# Autodesk Inventor assembly: Torso_estudio_B
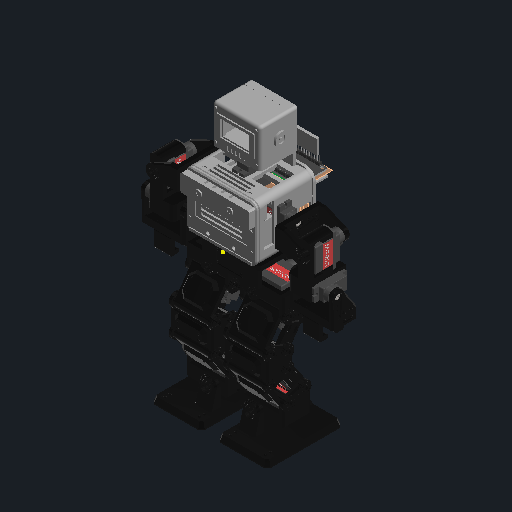
[picture p0: Inventor's stored thumbnail of the model, 512x512]
Saved by Autodesk Inventor 2027 (Build 310192060, 192F)
## iProperties
Part Number: Torso_estudio_B
Document SubType Name: Ensamblaje
Designer: rodri
Author: rodri
## Documents named in this file (31)
- C:\Users\rodri\Documents\PlatformIO\Projects\Proyecto Robot\CAD\Nuevo\Robot_armado_B.iam
- C:\Users\rodri\Documents\PlatformIO\Projects\Proyecto Robot\CAD\Nuevo\piezas_m3\Bracket01_B.ipt
- C:\Users\rodri\Documents\PlatformIO\Projects\Proyecto Robot\CAD\Nuevo\piezas_m3\Bracket03_B.ipt
- C:\Users\rodri\Documents\PlatformIO\Projects\Proyecto Robot\CAD\Nuevo\piezas_estilo\Bracket04_B.ipt
- C:\Users\rodri\Documents\PlatformIO\Projects\Proyecto Robot\CAD\Nuevo\piezas_estilo\Nee_B.ipt
- C:\Users\rodri\Documents\PlatformIO\Projects\Proyecto Robot\CAD\Nuevo\piezas_m3\Bracket02_W.ipt
- C:\Users\rodri\Documents\PlatformIO\Projects\Proyecto Robot\CAD\Nuevo\piezas_estilo\Link_W.ipt
- C:\Users\rodri\Documents\PlatformIO\Projects\Proyecto Robot\CAD\Nuevo\piezas_estilo\Bracket05_B.ipt
- C:\Users\rodri\Documents\PlatformIO\Projects\Proyecto Robot\CAD\Nuevo\piezas_m3\Spacer01_W.ipt
- C:\Users\rodri\Documents\PlatformIO\Projects\Proyecto Robot\CAD\Componentes\MG90S_grabcad_mg90s9.ipt
- C:\Users\rodri\Documents\PlatformIO\Projects\Proyecto Robot\CAD\Nuevo\piezas_estilo\Pelvis.ipt
- C:\Users\rodri\Documents\PlatformIO\Projects\Proyecto Robot\CAD\Nuevo\piezas_m3\Bracket07_B.ipt
- C:\Users\rodri\Documents\PlatformIO\Projects\Proyecto Robot\CAD\Nuevo\piezas_m3\Bracket09_W.ipt
- C:\Users\rodri\Documents\PlatformIO\Projects\Proyecto Robot\CAD\Nuevo\piezas_rediseno\Bracket11_B.ipt
- C:\Users\rodri\Documents\PlatformIO\Projects\Proyecto Robot\CAD\Nuevo\piezas_m3\Bracket08_B.ipt
- C:\Users\rodri\Documents\PlatformIO\Projects\Proyecto Robot\CAD\Nuevo\piezas_m3\Bracket10_W.ipt
- C:\Users\rodri\Documents\PlatformIO\Projects\Proyecto Robot\CAD\Nuevo\piezas_rediseno\Bracket12_B.ipt
- C:\Users\rodri\Documents\PlatformIO\Projects\Proyecto Robot\CAD\Componentes\PCA9685_adafruit_815.iam
- C:\Users\rodri\Documents\PlatformIO\Projects\Proyecto Robot\CAD\Componentes\ESP32_devkit_v1_30pin.iam
- C:\Users\rodri\Documents\PlatformIO\Projects\Proyecto Robot\CAD\Componentes\Bateria_LiPo_2S_1000_62x23x17.ipt
- C:\Users\rodri\Documents\PlatformIO\Projects\Proyecto Robot\CAD\Componentes\XL4015_52x12x24_acostado.ipt
- C:\Users\rodri\Documents\PlatformIO\Projects\Proyecto Robot\CAD\Componentes\IMU_GY521_21x16.ipt
- C:\Users\rodri\Documents\PlatformIO\Projects\Proyecto Robot\CAD\Componentes\Fichas_pines_IMU.ipt
- C:\Users\rodri\Documents\PlatformIO\Projects\Proyecto Robot\CAD\Componentes\Fichas_servos_PCA_atras.ipt
- C:\Users\rodri\Documents\PlatformIO\Projects\Proyecto Robot\CAD\Componentes\Fichas_pines_ESP32_atras14.ipt
- C:\Users\rodri\Documents\PlatformIO\Projects\Proyecto Robot\CAD\Nuevo\Torso_cuerpo_B.ipt
- C:\Users\rodri\Documents\PlatformIO\Projects\Proyecto Robot\CAD\Nuevo\Torso_pecho.ipt
- C:\Users\rodri\Documents\PlatformIO\Projects\Proyecto Robot\CAD\Nuevo\Torso_atras_B.ipt
- C:\Users\rodri\Documents\PlatformIO\Projects\Proyecto Robot\CAD\Nuevo\Cabeza_frente.ipt
- C:\Users\rodri\Documents\PlatformIO\Projects\Proyecto Robot\CAD\Nuevo\Cabeza_tapa.ipt
- C:\Users\rodri\Documents\PlatformIO\Projects\Proyecto Robot\CAD\Nuevo\piezas_m3\Pipe_M3.ipt
## Components (90 placed, 30 different names)
1. Bracket01_B:1 — Coincidencia:2, Nivelación:3, Nivelación:4, Coincidencia:31, Nivelación:61, Nivelación:62, Coincidencia:72, Nivelación:137, Coincidencia:78, Nivelación:143
2. Bracket03_B:1 — Coincidencia:3, Nivelación:5, Nivelación:6, Coincidencia:38, Nivelación:75, Nivelación:76, Coincidencia:84, Nivelación:149, Coincidencia:90
3. Bracket04_B:1 — Coincidencia:91, Nivelación:153
4. Nee_B:1 — Coincidencia:73, Nivelación:138, Coincidencia:74, Nivelación:139, Coincidencia:85, Coincidencia:86, Nivelación:150
5. Bracket02_W:1 — Coincidencia:4, Nivelación:7, Nivelación:8, Coincidencia:32, Nivelación:63, Nivelación:64, Coincidencia:39, Nivelación:77, Nivelación:78, Coincidencia:43, Nivelación:85, Nivelación:86, Coincidencia:85
6. Bracket02_W:2 — Coincidencia:5, Nivelación:9, Nivelación:10, Coincidencia:35, Nivelación:69, Nivelación:70, Coincidencia:40, Nivelación:79, Nivelación:80, Coincidencia:44, Nivelación:87, Nivelación:88, Coincidencia:86, Nivelación:150
7. Link_W:1 — Coincidencia:33, Nivelación:65, Nivelación:66, Coincidencia:34, Nivelación:67, Nivelación:68, Coincidencia:41, Nivelación:81, Nivelación:82, Coincidencia:45, Nivelación:89, Nivelación:90, Coincidencia:72, Nivelación:137, Coincidencia:73, Nivelación:138
8. Link_W:2 — Coincidencia:36, Nivelación:71, Nivelación:72, Coincidencia:37, Nivelación:73, Nivelación:74, Coincidencia:42, Nivelación:83, Nivelación:84, Coincidencia:46, Nivelación:91, Nivelación:92, Coincidencia:74, Nivelación:139, Coincidencia:84, Nivelación:149
9. Bracket03_B:2 — Coincidencia:6, Nivelación:11, Nivelación:12, Coincidencia:30, Nivelación:59, Nivelación:60, Coincidencia:75, Nivelación:140, Coincidencia:79, Nivelación:144
10. Bracket01_B:2 — Coincidencia:7, Nivelación:13, Nivelación:14, Coincidencia:53, Nivelación:105, Nivelación:106, Coincidencia:87, Nivelación:151, Coincidencia:92
11. Bracket05_B:1 — Coincidencia:93, Nivelación:154
12. Nee_B:2 — Coincidencia:76, Nivelación:141, Coincidencia:77, Nivelación:142, Coincidencia:88, Coincidencia:89, Nivelación:152
13. Bracket02_W:3 — Coincidencia:8, Nivelación:15, Nivelación:16, Coincidencia:47, Nivelación:93, Nivelación:94, Coincidencia:54, Nivelación:107, Nivelación:108, Coincidencia:58, Nivelación:115, Nivelación:116, Coincidencia:88
14. Bracket02_W:4 — Coincidencia:9, Nivelación:17, Nivelación:18, Coincidencia:50, Nivelación:99, Nivelación:100, Coincidencia:55, Nivelación:109, Nivelación:110, Coincidencia:59, Nivelación:117, Nivelación:118, Coincidencia:89, Nivelación:152
15. Link_W:3 — Coincidencia:48, Nivelación:95, Nivelación:96, Coincidencia:49, Nivelación:97, Nivelación:98, Coincidencia:56, Nivelación:111, Nivelación:112, Coincidencia:60, Nivelación:119, Nivelación:120, Coincidencia:75, Nivelación:140, Coincidencia:76, Nivelación:141
16. Link_W:4 — Coincidencia:51, Nivelación:101, Nivelación:102, Coincidencia:52, Nivelación:103, Nivelación:104, Coincidencia:57, Nivelación:113, Nivelación:114, Coincidencia:61, Nivelación:121, Nivelación:122, Coincidencia:77, Nivelación:142, Coincidencia:87, Nivelación:151
17. Spacer01_W:1 — Coincidencia:1, Nivelación:1, Nivelación:2
18. MG90S_grabcad_mg90s9:1 — Coincidencia:2, Nivelación:3, Nivelación:4, Coincidencia:68, Nivelación:133
19. MG90S_grabcad_mg90s9:2 — Coincidencia:3, Nivelación:5, Nivelación:6, Coincidencia:91, Nivelación:153
20. MG90S_grabcad_mg90s9:3 — Coincidencia:4, Nivelación:7, Nivelación:8, Coincidencia:78, Nivelación:143
21. MG90S_grabcad_mg90s9:4 — Coincidencia:5, Nivelación:9, Nivelación:10, Coincidencia:90
22. MG90S_grabcad_mg90s9:5 — Coincidencia:6, Nivelación:11, Nivelación:12, Coincidencia:67, Nivelación:132
23. MG90S_grabcad_mg90s9:6 — Coincidencia:7, Nivelación:13, Nivelación:14, Coincidencia:93, Nivelación:154
24. MG90S_grabcad_mg90s9:7 — Coincidencia:8, Nivelación:15, Nivelación:16, Coincidencia:79, Nivelación:144
25. MG90S_grabcad_mg90s9:8 — Coincidencia:9, Nivelación:17, Nivelación:18, Coincidencia:92
26. MG90S_grabcad_mg90s9:9 — Coincidencia:10, Nivelación:19, Nivelación:20, Coincidencia:66, Nivelación:131
27. MG90S_grabcad_mg90s9:10 — Coincidencia:11, Nivelación:21, Nivelación:22, Coincidencia:71, Nivelación:136
28. Pelvis:1 — Coincidencia:66, Nivelación:131, Coincidencia:67, Nivelación:132, Coincidencia:68, Nivelación:133
29. MG90S_grabcad_mg90s9:11 — Coincidencia:12, Nivelación:23, Nivelación:24, Coincidencia:69, Nivelación:134
30. MG90S_grabcad_mg90s9:12 — Coincidencia:13, Nivelación:25, Nivelación:26, Coincidencia:70, Nivelación:135
31. Bracket07_B:1 — Coincidencia:69, Nivelación:134, Coincidencia:80, Nivelación:145
32. Bracket09_W:1 — Coincidencia:14, Nivelación:27, Nivelación:28, Coincidencia:15, Nivelación:29, Nivelación:30, Coincidencia:62, Nivelación:123, Nivelación:124, Coincidencia:63, Nivelación:125, Nivelación:126
33. Bracket11_B:1 — Coincidencia:81, Nivelación:146
34. Bracket08_B:1 — Coincidencia:70, Nivelación:135, Coincidencia:82, Nivelación:147
35. Bracket10_W:1 — Coincidencia:16, Nivelación:31, Nivelación:32, Coincidencia:17, Nivelación:33, Nivelación:34, Coincidencia:64, Nivelación:127, Nivelación:128, Coincidencia:65, Nivelación:129, Nivelación:130
36. Bracket12_B:1 — Coincidencia:83, Nivelación:148
37. MG90S_grabcad_mg90s9:13 — Coincidencia:14, Nivelación:27, Nivelación:28, Coincidencia:81, Nivelación:146
38. MG90S_grabcad_mg90s9:14 — Coincidencia:15, Nivelación:29, Nivelación:30, Coincidencia:80, Nivelación:145
39. MG90S_grabcad_mg90s9:15 — Coincidencia:16, Nivelación:31, Nivelación:32, Coincidencia:83, Nivelación:148
40. MG90S_grabcad_mg90s9:16 — Coincidencia:17, Nivelación:33, Nivelación:34, Coincidencia:82, Nivelación:147
41. PCA9685_adafruit_815:1 [sub-assembly] — Coincidencia:18, Nivelación:35, Nivelación:36
42. ESP32_devkit_v1_30pin:1 [sub-assembly] — Coincidencia:19, Nivelación:37, Nivelación:38
43. Bateria_LiPo_2S_1000_62x23x17:1 — Coincidencia:20, Nivelación:39, Nivelación:40
44. XL4015_52x12x24_acostado:1 — Coincidencia:21, Nivelación:41, Nivelación:42
45. IMU_GY521_21x16:1 — Coincidencia:22, Nivelación:43, Nivelación:44
46. Fichas_pines_IMU:1 — Coincidencia:23, Nivelación:45, Nivelación:46
47. Fichas_servos_PCA_atras:1 — Coincidencia:24, Nivelación:47, Nivelación:48
48. Fichas_pines_ESP32_atras14:1 — Coincidencia:25, Nivelación:49, Nivelación:50
49. Fichas_pines_ESP32_atras14:2 — Coincidencia:26, Nivelación:51, Nivelación:52
50. Torso_cuerpo_B:1 — Coincidencia:1, Nivelación:1, Nivelación:2, Coincidencia:10, Nivelación:19, Nivelación:20, Coincidencia:11, Nivelación:21, Nivelación:22, Coincidencia:12, Nivelación:23, Nivelación:24, Coincidencia:13, Nivelación:25, Nivelación:26, Coincidencia:18, Nivelación:35, Nivelación:36, Coincidencia:19, Nivelación:37, Nivelación:38, Coincidencia:20, Nivelación:39, Nivelación:40, Coincidencia:21, Nivelación:41, Nivelación:42, Coincidencia:22, Nivelación:43, Nivelación:44, Coincidencia:23, Nivelación:45, Nivelación:46, Coincidencia:24, Nivelación:47, Nivelación:48, Coincidencia:25, Nivelación:49, Nivelación:50, Coincidencia:26, Nivelación:51, Nivelación:52, Coincidencia:27, Nivelación:53, Nivelación:54, Coincidencia:28, Nivelación:55, Nivelación:56
51. Torso_pecho:1 — Coincidencia:27, Nivelación:53, Nivelación:54
52. Torso_atras_B:1 — Coincidencia:28, Nivelación:55, Nivelación:56
53. Cabeza_frente:1 — Coincidencia:29, Nivelación:57, Nivelación:58, Coincidencia:71, Nivelación:136
54. Cabeza_tapa:1 — Coincidencia:29, Nivelación:57, Nivelación:58
55. Pipe_M3:1 — Coincidencia:30, Nivelación:59, Nivelación:60
56. Pipe_M3:2 — Coincidencia:31, Nivelación:61, Nivelación:62
57. Pipe_M3:3 — Coincidencia:32, Nivelación:63, Nivelación:64
58. Pipe_M3:4 — Coincidencia:33, Nivelación:65, Nivelación:66
59. Pipe_M3:5 — Coincidencia:34, Nivelación:67, Nivelación:68
60. Pipe_M3:6 — Coincidencia:35, Nivelación:69, Nivelación:70
61. Pipe_M3:7 — Coincidencia:36, Nivelación:71, Nivelación:72
62. Pipe_M3:8 — Coincidencia:37, Nivelación:73, Nivelación:74
63. Pipe_M3:9 — Coincidencia:38, Nivelación:75, Nivelación:76
64. Pipe_M3:10 — Coincidencia:39, Nivelación:77, Nivelación:78
65. Pipe_M3:11 — Coincidencia:40, Nivelación:79, Nivelación:80
66. Pipe_M3:12 — Coincidencia:41, Nivelación:81, Nivelación:82
67. Pipe_M3:13 — Coincidencia:42, Nivelación:83, Nivelación:84
68. Pipe_M3:14 — Coincidencia:43, Nivelación:85, Nivelación:86
69. Pipe_M3:15 — Coincidencia:44, Nivelación:87, Nivelación:88
70. Pipe_M3:16 — Coincidencia:45, Nivelación:89, Nivelación:90
71. Pipe_M3:17 — Coincidencia:46, Nivelación:91, Nivelación:92
72. Pipe_M3:18 — Coincidencia:47, Nivelación:93, Nivelación:94
73. Pipe_M3:19 — Coincidencia:48, Nivelación:95, Nivelación:96
74. Pipe_M3:20 — Coincidencia:49, Nivelación:97, Nivelación:98
75. Pipe_M3:21 — Coincidencia:50, Nivelación:99, Nivelación:100
76. Pipe_M3:22 — Coincidencia:51, Nivelación:101, Nivelación:102
77. Pipe_M3:23 — Coincidencia:52, Nivelación:103, Nivelación:104
78. Pipe_M3:24 — Coincidencia:53, Nivelación:105, Nivelación:106
79. Pipe_M3:25 — Coincidencia:54, Nivelación:107, Nivelación:108
80. Pipe_M3:26 — Coincidencia:55, Nivelación:109, Nivelación:110
81. Pipe_M3:27 — Coincidencia:56, Nivelación:111, Nivelación:112
82. Pipe_M3:28 — Coincidencia:57, Nivelación:113, Nivelación:114
83. Pipe_M3:29 — Coincidencia:58, Nivelación:115, Nivelación:116
84. Pipe_M3:30 — Coincidencia:59, Nivelación:117, Nivelación:118
85. Pipe_M3:31 — Coincidencia:60, Nivelación:119, Nivelación:120
86. Pipe_M3:32 — Coincidencia:61, Nivelación:121, Nivelación:122
87. Pipe_M3:33 — Coincidencia:62, Nivelación:123, Nivelación:124
88. Pipe_M3:34 — Coincidencia:63, Nivelación:125, Nivelación:126
89. Pipe_M3:35 — Coincidencia:64, Nivelación:127, Nivelación:128
90. Pipe_M3:36 — Coincidencia:65, Nivelación:129, Nivelación:130
## Relationships (247: Flush 154, Mate 93)
- Coincidencia:1 [Mate]: Spacer01_W:1 ↔ Torso_cuerpo_B:1
- Nivelación:1 [Flush]: Spacer01_W:1 ↔ Torso_cuerpo_B:1
- Nivelación:2 [Flush]: Spacer01_W:1 ↔ Torso_cuerpo_B:1
- Coincidencia:2 [Mate]: Bracket01_B:1 ↔ MG90S_grabcad_mg90s9:1
- Nivelación:3 [Flush]: Bracket01_B:1 ↔ MG90S_grabcad_mg90s9:1
- Nivelación:4 [Flush]: Bracket01_B:1 ↔ MG90S_grabcad_mg90s9:1
- Coincidencia:3 [Mate]: Bracket03_B:1 ↔ MG90S_grabcad_mg90s9:2
- Nivelación:5 [Flush]: Bracket03_B:1 ↔ MG90S_grabcad_mg90s9:2
- Nivelación:6 [Flush]: Bracket03_B:1 ↔ MG90S_grabcad_mg90s9:2
- Coincidencia:4 [Mate]: Bracket02_W:1 ↔ MG90S_grabcad_mg90s9:3
- Nivelación:7 [Flush]: Bracket02_W:1 ↔ MG90S_grabcad_mg90s9:3
- Nivelación:8 [Flush]: Bracket02_W:1 ↔ MG90S_grabcad_mg90s9:3
- Coincidencia:5 [Mate]: Bracket02_W:2 ↔ MG90S_grabcad_mg90s9:4
- Nivelación:9 [Flush]: Bracket02_W:2 ↔ MG90S_grabcad_mg90s9:4
- Nivelación:10 [Flush]: Bracket02_W:2 ↔ MG90S_grabcad_mg90s9:4
- Coincidencia:6 [Mate]: Bracket03_B:2 ↔ MG90S_grabcad_mg90s9:5
- Nivelación:11 [Flush]: Bracket03_B:2 ↔ MG90S_grabcad_mg90s9:5
- Nivelación:12 [Flush]: Bracket03_B:2 ↔ MG90S_grabcad_mg90s9:5
- Coincidencia:7 [Mate]: Bracket01_B:2 ↔ MG90S_grabcad_mg90s9:6
- Nivelación:13 [Flush]: Bracket01_B:2 ↔ MG90S_grabcad_mg90s9:6
- Nivelación:14 [Flush]: Bracket01_B:2 ↔ MG90S_grabcad_mg90s9:6
- Coincidencia:8 [Mate]: Bracket02_W:3 ↔ MG90S_grabcad_mg90s9:7
- Nivelación:15 [Flush]: Bracket02_W:3 ↔ MG90S_grabcad_mg90s9:7
- Nivelación:16 [Flush]: Bracket02_W:3 ↔ MG90S_grabcad_mg90s9:7
- Coincidencia:9 [Mate]: Bracket02_W:4 ↔ MG90S_grabcad_mg90s9:8
- Nivelación:17 [Flush]: Bracket02_W:4 ↔ MG90S_grabcad_mg90s9:8
- Nivelación:18 [Flush]: Bracket02_W:4 ↔ MG90S_grabcad_mg90s9:8
- Coincidencia:10 [Mate]: MG90S_grabcad_mg90s9:9 ↔ Torso_cuerpo_B:1
- Nivelación:19 [Flush]: MG90S_grabcad_mg90s9:9 ↔ Torso_cuerpo_B:1
- Nivelación:20 [Flush]: MG90S_grabcad_mg90s9:9 ↔ Torso_cuerpo_B:1
- Coincidencia:11 [Mate]: MG90S_grabcad_mg90s9:10 ↔ Torso_cuerpo_B:1
- Nivelación:21 [Flush]: MG90S_grabcad_mg90s9:10 ↔ Torso_cuerpo_B:1
- Nivelación:22 [Flush]: MG90S_grabcad_mg90s9:10 ↔ Torso_cuerpo_B:1
- Coincidencia:12 [Mate]: MG90S_grabcad_mg90s9:11 ↔ Torso_cuerpo_B:1
- Nivelación:23 [Flush]: MG90S_grabcad_mg90s9:11 ↔ Torso_cuerpo_B:1
- Nivelación:24 [Flush]: MG90S_grabcad_mg90s9:11 ↔ Torso_cuerpo_B:1
- Coincidencia:13 [Mate]: MG90S_grabcad_mg90s9:12 ↔ Torso_cuerpo_B:1
- Nivelación:25 [Flush]: MG90S_grabcad_mg90s9:12 ↔ Torso_cuerpo_B:1
- Nivelación:26 [Flush]: MG90S_grabcad_mg90s9:12 ↔ Torso_cuerpo_B:1
- Coincidencia:14 [Mate]: Bracket09_W:1 ↔ MG90S_grabcad_mg90s9:13
- Nivelación:27 [Flush]: Bracket09_W:1 ↔ MG90S_grabcad_mg90s9:13
- Nivelación:28 [Flush]: Bracket09_W:1 ↔ MG90S_grabcad_mg90s9:13
- Coincidencia:15 [Mate]: Bracket09_W:1 ↔ MG90S_grabcad_mg90s9:14
- Nivelación:29 [Flush]: Bracket09_W:1 ↔ MG90S_grabcad_mg90s9:14
- Nivelación:30 [Flush]: Bracket09_W:1 ↔ MG90S_grabcad_mg90s9:14
- Coincidencia:16 [Mate]: Bracket10_W:1 ↔ MG90S_grabcad_mg90s9:15
- Nivelación:31 [Flush]: Bracket10_W:1 ↔ MG90S_grabcad_mg90s9:15
- Nivelación:32 [Flush]: Bracket10_W:1 ↔ MG90S_grabcad_mg90s9:15
- Coincidencia:17 [Mate]: Bracket10_W:1 ↔ MG90S_grabcad_mg90s9:16
- Nivelación:33 [Flush]: Bracket10_W:1 ↔ MG90S_grabcad_mg90s9:16
- Nivelación:34 [Flush]: Bracket10_W:1 ↔ MG90S_grabcad_mg90s9:16
- Coincidencia:18 [Mate]: PCA9685_adafruit_815:1 ↔ Torso_cuerpo_B:1
- Nivelación:35 [Flush]: PCA9685_adafruit_815:1 ↔ Torso_cuerpo_B:1
- Nivelación:36 [Flush]: PCA9685_adafruit_815:1 ↔ Torso_cuerpo_B:1
- Coincidencia:19 [Mate]: ESP32_devkit_v1_30pin:1 ↔ Torso_cuerpo_B:1
- Nivelación:37 [Flush]: ESP32_devkit_v1_30pin:1 ↔ Torso_cuerpo_B:1
- Nivelación:38 [Flush]: ESP32_devkit_v1_30pin:1 ↔ Torso_cuerpo_B:1
- Coincidencia:20 [Mate]: Bateria_LiPo_2S_1000_62x23x17:1 ↔ Torso_cuerpo_B:1
- Nivelación:39 [Flush]: Bateria_LiPo_2S_1000_62x23x17:1 ↔ Torso_cuerpo_B:1
- Nivelación:40 [Flush]: Bateria_LiPo_2S_1000_62x23x17:1 ↔ Torso_cuerpo_B:1
- Coincidencia:21 [Mate]: XL4015_52x12x24_acostado:1 ↔ Torso_cuerpo_B:1
- Nivelación:41 [Flush]: XL4015_52x12x24_acostado:1 ↔ Torso_cuerpo_B:1
- Nivelación:42 [Flush]: XL4015_52x12x24_acostado:1 ↔ Torso_cuerpo_B:1
- Coincidencia:22 [Mate]: IMU_GY521_21x16:1 ↔ Torso_cuerpo_B:1
- Nivelación:43 [Flush]: IMU_GY521_21x16:1 ↔ Torso_cuerpo_B:1
- Nivelación:44 [Flush]: IMU_GY521_21x16:1 ↔ Torso_cuerpo_B:1
- Coincidencia:23 [Mate]: Fichas_pines_IMU:1 ↔ Torso_cuerpo_B:1
- Nivelación:45 [Flush]: Fichas_pines_IMU:1 ↔ Torso_cuerpo_B:1
- Nivelación:46 [Flush]: Fichas_pines_IMU:1 ↔ Torso_cuerpo_B:1
- Coincidencia:24 [Mate]: Fichas_servos_PCA_atras:1 ↔ Torso_cuerpo_B:1
- Nivelación:47 [Flush]: Fichas_servos_PCA_atras:1 ↔ Torso_cuerpo_B:1
- Nivelación:48 [Flush]: Fichas_servos_PCA_atras:1 ↔ Torso_cuerpo_B:1
- Coincidencia:25 [Mate]: Fichas_pines_ESP32_atras14:1 ↔ Torso_cuerpo_B:1
- Nivelación:49 [Flush]: Fichas_pines_ESP32_atras14:1 ↔ Torso_cuerpo_B:1
- Nivelación:50 [Flush]: Fichas_pines_ESP32_atras14:1 ↔ Torso_cuerpo_B:1
- Coincidencia:26 [Mate]: Fichas_pines_ESP32_atras14:2 ↔ Torso_cuerpo_B:1
- Nivelación:51 [Flush]: Fichas_pines_ESP32_atras14:2 ↔ Torso_cuerpo_B:1
- Nivelación:52 [Flush]: Fichas_pines_ESP32_atras14:2 ↔ Torso_cuerpo_B:1
- Coincidencia:27 [Mate]: Torso_cuerpo_B:1 ↔ Torso_pecho:1
- Nivelación:53 [Flush]: Torso_cuerpo_B:1 ↔ Torso_pecho:1
- Nivelación:54 [Flush]: Torso_cuerpo_B:1 ↔ Torso_pecho:1
- Coincidencia:28 [Mate]: Torso_cuerpo_B:1 ↔ Torso_atras_B:1
- Nivelación:55 [Flush]: Torso_cuerpo_B:1 ↔ Torso_atras_B:1
- Nivelación:56 [Flush]: Torso_cuerpo_B:1 ↔ Torso_atras_B:1
- Coincidencia:29 [Mate]: Cabeza_frente:1 ↔ Cabeza_tapa:1
- Nivelación:57 [Flush]: Cabeza_frente:1 ↔ Cabeza_tapa:1
- Nivelación:58 [Flush]: Cabeza_frente:1 ↔ Cabeza_tapa:1
- Coincidencia:30 [Mate]: Bracket03_B:2 ↔ Pipe_M3:1
- Nivelación:59 [Flush]: Bracket03_B:2 ↔ Pipe_M3:1
- Nivelación:60 [Flush]: Bracket03_B:2 ↔ Pipe_M3:1
- Coincidencia:31 [Mate]: Bracket01_B:1 ↔ Pipe_M3:2
- Nivelación:61 [Flush]: Bracket01_B:1 ↔ Pipe_M3:2
- Nivelación:62 [Flush]: Bracket01_B:1 ↔ Pipe_M3:2
- Coincidencia:32 [Mate]: Bracket02_W:1 ↔ Pipe_M3:3
- Nivelación:63 [Flush]: Bracket02_W:1 ↔ Pipe_M3:3
- Nivelación:64 [Flush]: Bracket02_W:1 ↔ Pipe_M3:3
- Coincidencia:33 [Mate]: Link_W:1 ↔ Pipe_M3:4
- Nivelación:65 [Flush]: Link_W:1 ↔ Pipe_M3:4
- Nivelación:66 [Flush]: Link_W:1 ↔ Pipe_M3:4
- Coincidencia:34 [Mate]: Link_W:1 ↔ Pipe_M3:5
- Nivelación:67 [Flush]: Link_W:1 ↔ Pipe_M3:5
- Nivelación:68 [Flush]: Link_W:1 ↔ Pipe_M3:5
- Coincidencia:35 [Mate]: Bracket02_W:2 ↔ Pipe_M3:6
- Nivelación:69 [Flush]: Bracket02_W:2 ↔ Pipe_M3:6
- Nivelación:70 [Flush]: Bracket02_W:2 ↔ Pipe_M3:6
- Coincidencia:36 [Mate]: Link_W:2 ↔ Pipe_M3:7
- Nivelación:71 [Flush]: Link_W:2 ↔ Pipe_M3:7
- Nivelación:72 [Flush]: Link_W:2 ↔ Pipe_M3:7
- Coincidencia:37 [Mate]: Link_W:2 ↔ Pipe_M3:8
- Nivelación:73 [Flush]: Link_W:2 ↔ Pipe_M3:8
- Nivelación:74 [Flush]: Link_W:2 ↔ Pipe_M3:8
- Coincidencia:38 [Mate]: Bracket03_B:1 ↔ Pipe_M3:9
- Nivelación:75 [Flush]: Bracket03_B:1 ↔ Pipe_M3:9
- Nivelación:76 [Flush]: Bracket03_B:1 ↔ Pipe_M3:9
- Coincidencia:39 [Mate]: Bracket02_W:1 ↔ Pipe_M3:10
- Nivelación:77 [Flush]: Bracket02_W:1 ↔ Pipe_M3:10
- Nivelación:78 [Flush]: Bracket02_W:1 ↔ Pipe_M3:10
- Coincidencia:40 [Mate]: Bracket02_W:2 ↔ Pipe_M3:11
- Nivelación:79 [Flush]: Bracket02_W:2 ↔ Pipe_M3:11
- Nivelación:80 [Flush]: Bracket02_W:2 ↔ Pipe_M3:11
- Coincidencia:41 [Mate]: Link_W:1 ↔ Pipe_M3:12
- Nivelación:81 [Flush]: Link_W:1 ↔ Pipe_M3:12
- Nivelación:82 [Flush]: Link_W:1 ↔ Pipe_M3:12
- Coincidencia:42 [Mate]: Link_W:2 ↔ Pipe_M3:13
- Nivelación:83 [Flush]: Link_W:2 ↔ Pipe_M3:13
- Nivelación:84 [Flush]: Link_W:2 ↔ Pipe_M3:13
- Coincidencia:43 [Mate]: Bracket02_W:1 ↔ Pipe_M3:14
- Nivelación:85 [Flush]: Bracket02_W:1 ↔ Pipe_M3:14
- Nivelación:86 [Flush]: Bracket02_W:1 ↔ Pipe_M3:14
- Coincidencia:44 [Mate]: Bracket02_W:2 ↔ Pipe_M3:15
- Nivelación:87 [Flush]: Bracket02_W:2 ↔ Pipe_M3:15
- Nivelación:88 [Flush]: Bracket02_W:2 ↔ Pipe_M3:15
- Coincidencia:45 [Mate]: Link_W:1 ↔ Pipe_M3:16
- Nivelación:89 [Flush]: Link_W:1 ↔ Pipe_M3:16
- Nivelación:90 [Flush]: Link_W:1 ↔ Pipe_M3:16
- Coincidencia:46 [Mate]: Link_W:2 ↔ Pipe_M3:17
- Nivelación:91 [Flush]: Link_W:2 ↔ Pipe_M3:17
- Nivelación:92 [Flush]: Link_W:2 ↔ Pipe_M3:17
- Coincidencia:47 [Mate]: Bracket02_W:3 ↔ Pipe_M3:18
- Nivelación:93 [Flush]: Bracket02_W:3 ↔ Pipe_M3:18
- Nivelación:94 [Flush]: Bracket02_W:3 ↔ Pipe_M3:18
- Coincidencia:48 [Mate]: Link_W:3 ↔ Pipe_M3:19
- Nivelación:95 [Flush]: Link_W:3 ↔ Pipe_M3:19
- Nivelación:96 [Flush]: Link_W:3 ↔ Pipe_M3:19
- Coincidencia:49 [Mate]: Link_W:3 ↔ Pipe_M3:20
- Nivelación:97 [Flush]: Link_W:3 ↔ Pipe_M3:20
- Nivelación:98 [Flush]: Link_W:3 ↔ Pipe_M3:20
- Coincidencia:50 [Mate]: Bracket02_W:4 ↔ Pipe_M3:21
- Nivelación:99 [Flush]: Bracket02_W:4 ↔ Pipe_M3:21
- Nivelación:100 [Flush]: Bracket02_W:4 ↔ Pipe_M3:21
- Coincidencia:51 [Mate]: Link_W:4 ↔ Pipe_M3:22
- Nivelación:101 [Flush]: Link_W:4 ↔ Pipe_M3:22
- Nivelación:102 [Flush]: Link_W:4 ↔ Pipe_M3:22
- Coincidencia:52 [Mate]: Link_W:4 ↔ Pipe_M3:23
- Nivelación:103 [Flush]: Link_W:4 ↔ Pipe_M3:23
- Nivelación:104 [Flush]: Link_W:4 ↔ Pipe_M3:23
- Coincidencia:53 [Mate]: Bracket01_B:2 ↔ Pipe_M3:24
- Nivelación:105 [Flush]: Bracket01_B:2 ↔ Pipe_M3:24
- Nivelación:106 [Flush]: Bracket01_B:2 ↔ Pipe_M3:24
- Coincidencia:54 [Mate]: Bracket02_W:3 ↔ Pipe_M3:25
- Nivelación:107 [Flush]: Bracket02_W:3 ↔ Pipe_M3:25
- Nivelación:108 [Flush]: Bracket02_W:3 ↔ Pipe_M3:25
- Coincidencia:55 [Mate]: Bracket02_W:4 ↔ Pipe_M3:26
- Nivelación:109 [Flush]: Bracket02_W:4 ↔ Pipe_M3:26
- Nivelación:110 [Flush]: Bracket02_W:4 ↔ Pipe_M3:26
- Coincidencia:56 [Mate]: Link_W:3 ↔ Pipe_M3:27
- Nivelación:111 [Flush]: Link_W:3 ↔ Pipe_M3:27
- Nivelación:112 [Flush]: Link_W:3 ↔ Pipe_M3:27
- Coincidencia:57 [Mate]: Link_W:4 ↔ Pipe_M3:28
- Nivelación:113 [Flush]: Link_W:4 ↔ Pipe_M3:28
- Nivelación:114 [Flush]: Link_W:4 ↔ Pipe_M3:28
- Coincidencia:58 [Mate]: Bracket02_W:3 ↔ Pipe_M3:29
- Nivelación:115 [Flush]: Bracket02_W:3 ↔ Pipe_M3:29
- Nivelación:116 [Flush]: Bracket02_W:3 ↔ Pipe_M3:29
- Coincidencia:59 [Mate]: Bracket02_W:4 ↔ Pipe_M3:30
- Nivelación:117 [Flush]: Bracket02_W:4 ↔ Pipe_M3:30
- Nivelación:118 [Flush]: Bracket02_W:4 ↔ Pipe_M3:30
- Coincidencia:60 [Mate]: Link_W:3 ↔ Pipe_M3:31
- Nivelación:119 [Flush]: Link_W:3 ↔ Pipe_M3:31
- Nivelación:120 [Flush]: Link_W:3 ↔ Pipe_M3:31
- Coincidencia:61 [Mate]: Link_W:4 ↔ Pipe_M3:32
- Nivelación:121 [Flush]: Link_W:4 ↔ Pipe_M3:32
- Nivelación:122 [Flush]: Link_W:4 ↔ Pipe_M3:32
- Coincidencia:62 [Mate]: Bracket09_W:1 ↔ Pipe_M3:33
- Nivelación:123 [Flush]: Bracket09_W:1 ↔ Pipe_M3:33
- Nivelación:124 [Flush]: Bracket09_W:1 ↔ Pipe_M3:33
- Coincidencia:63 [Mate]: Bracket09_W:1 ↔ Pipe_M3:34
- Nivelación:125 [Flush]: Bracket09_W:1 ↔ Pipe_M3:34
- Nivelación:126 [Flush]: Bracket09_W:1 ↔ Pipe_M3:34
- Coincidencia:64 [Mate]: Bracket10_W:1 ↔ Pipe_M3:35
- Nivelación:127 [Flush]: Bracket10_W:1 ↔ Pipe_M3:35
- Nivelación:128 [Flush]: Bracket10_W:1 ↔ Pipe_M3:35
- Coincidencia:65 [Mate]: Bracket10_W:1 ↔ Pipe_M3:36
- Nivelación:129 [Flush]: Bracket10_W:1 ↔ Pipe_M3:36
- Nivelación:130 [Flush]: Bracket10_W:1 ↔ Pipe_M3:36
- Coincidencia:66 [Mate]: MG90S_grabcad_mg90s9:9 ↔ Pelvis:1
- Nivelación:131 [Flush]: MG90S_grabcad_mg90s9:9 ↔ Pelvis:1
- Coincidencia:67 [Mate]: MG90S_grabcad_mg90s9:5 ↔ Pelvis:1
- Nivelación:132 [Flush]: MG90S_grabcad_mg90s9:5 ↔ Pelvis:1
- Coincidencia:68 [Mate]: MG90S_grabcad_mg90s9:1 ↔ Pelvis:1
- Nivelación:133 [Flush]: MG90S_grabcad_mg90s9:1 ↔ Pelvis:1
- Coincidencia:69 [Mate]: MG90S_grabcad_mg90s9:11 ↔ Bracket07_B:1
- Nivelación:134 [Flush]: MG90S_grabcad_mg90s9:11 ↔ Bracket07_B:1
- Coincidencia:70 [Mate]: MG90S_grabcad_mg90s9:12 ↔ Bracket08_B:1
- Nivelación:135 [Flush]: MG90S_grabcad_mg90s9:12 ↔ Bracket08_B:1
- Coincidencia:71 [Mate]: MG90S_grabcad_mg90s9:10 ↔ Cabeza_frente:1
- Nivelación:136 [Flush]: MG90S_grabcad_mg90s9:10 ↔ Cabeza_frente:1
- Coincidencia:72 [Mate]: Bracket01_B:1 ↔ Link_W:1
- Nivelación:137 [Flush]: Bracket01_B:1 ↔ Link_W:1
- Coincidencia:73 [Mate]: Nee_B:1 ↔ Link_W:1
- Nivelación:138 [Flush]: Nee_B:1 ↔ Link_W:1
- Coincidencia:74 [Mate]: Nee_B:1 ↔ Link_W:2
- Nivelación:139 [Flush]: Nee_B:1 ↔ Link_W:2
- Coincidencia:75 [Mate]: Bracket03_B:2 ↔ Link_W:3
- Nivelación:140 [Flush]: Bracket03_B:2 ↔ Link_W:3
- Coincidencia:76 [Mate]: Nee_B:2 ↔ Link_W:3
- Nivelación:141 [Flush]: Nee_B:2 ↔ Link_W:3
- Coincidencia:77 [Mate]: Nee_B:2 ↔ Link_W:4
- Nivelación:142 [Flush]: Nee_B:2 ↔ Link_W:4
- Coincidencia:78 [Mate]: Bracket01_B:1 ↔ MG90S_grabcad_mg90s9:3
- Nivelación:143 [Flush]: Bracket01_B:1 ↔ MG90S_grabcad_mg90s9:3
- Coincidencia:79 [Mate]: Bracket03_B:2 ↔ MG90S_grabcad_mg90s9:7
- Nivelación:144 [Flush]: Bracket03_B:2 ↔ MG90S_grabcad_mg90s9:7
- Coincidencia:80 [Mate]: Bracket07_B:1 ↔ MG90S_grabcad_mg90s9:14
- Nivelación:145 [Flush]: Bracket07_B:1 ↔ MG90S_grabcad_mg90s9:14
- Coincidencia:81 [Mate]: Bracket11_B:1 ↔ MG90S_grabcad_mg90s9:13
- Nivelación:146 [Flush]: Bracket11_B:1 ↔ MG90S_grabcad_mg90s9:13
- Coincidencia:82 [Mate]: Bracket08_B:1 ↔ MG90S_grabcad_mg90s9:16
- Nivelación:147 [Flush]: Bracket08_B:1 ↔ MG90S_grabcad_mg90s9:16
- Coincidencia:83 [Mate]: Bracket12_B:1 ↔ MG90S_grabcad_mg90s9:15
- Nivelación:148 [Flush]: Bracket12_B:1 ↔ MG90S_grabcad_mg90s9:15
- Coincidencia:84 [Mate]: Bracket03_B:1 ↔ Link_W:2
- Nivelación:149 [Flush]: Bracket03_B:1 ↔ Link_W:2
- Coincidencia:85 [Mate]: Nee_B:1 ↔ Bracket02_W:1
- Coincidencia:86 [Mate]: Nee_B:1 ↔ Bracket02_W:2
- Nivelación:150 [Flush]: Nee_B:1 ↔ Bracket02_W:2
- Coincidencia:87 [Mate]: Bracket01_B:2 ↔ Link_W:4
- Nivelación:151 [Flush]: Bracket01_B:2 ↔ Link_W:4
- Coincidencia:88 [Mate]: Nee_B:2 ↔ Bracket02_W:3
- Coincidencia:89 [Mate]: Nee_B:2 ↔ Bracket02_W:4
- Nivelación:152 [Flush]: Nee_B:2 ↔ Bracket02_W:4
- Coincidencia:90 [Mate]: Bracket03_B:1 ↔ MG90S_grabcad_mg90s9:4
- Coincidencia:91 [Mate]: Bracket04_B:1 ↔ MG90S_grabcad_mg90s9:2
- Nivelación:153 [Flush]: Bracket04_B:1 ↔ MG90S_grabcad_mg90s9:2
- Coincidencia:92 [Mate]: Bracket01_B:2 ↔ MG90S_grabcad_mg90s9:8
- Coincidencia:93 [Mate]: Bracket05_B:1 ↔ MG90S_grabcad_mg90s9:6
- Nivelación:154 [Flush]: Bracket05_B:1 ↔ MG90S_grabcad_mg90s9:6
